# Autodesk Inventor assembly: MM0937AN200_G03_803
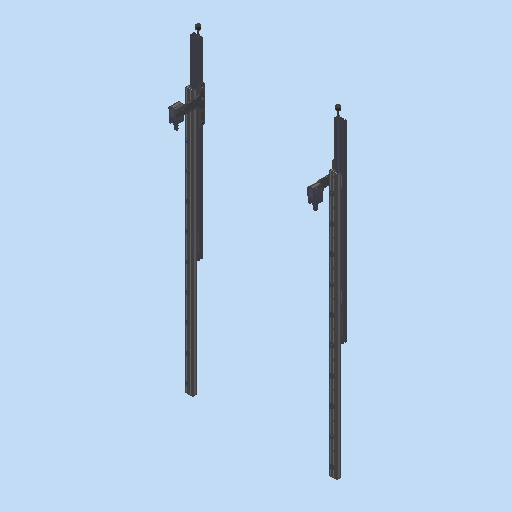
[picture p0: Inventor's stored thumbnail of the model, 512x512]
Saved by Autodesk Inventor 2023.3 (Build 273359000, 359)
## iProperties
Created: 2020-09-01
Part Number: MM0937AN200_G03_803
Material: Generisch
Document SubType Name: Assembly
Designer: Benutzer
Mass: 4640.54 g
Surface Area: 11097.1 cm^2
Volume: 1801.38 cm^3
Density: 2.5761 g/cm^3
Description: =<RBPARTNOTITLE2>
Author: ac91sw
Title: LR_SCHIENE_U_FO_ASM
Sending System: CREO PARAMETRIC BY PTC INC, 2018420
Preprocessor: CREO PARAMETRIC BY PTC INC, 2018420
RBPARTNOTITLE1: Führung
AnP_Kategorie: 1
AnP_Material: =<Material>
RBDRAWINGMISSINGSPEC: --
RBPARTMADEOF: --
RBPARTNOTITLE2: Führungen
RBMATERIAL: =<Material>
RBMATNO: =<Part Number>
Author: Benutzer
Revision Number: 01
Keywords: =<RBPARTMADEOF>
Comments: =<RBSURFACE2>
## Documents named in this file (13)
- C:\Users\rea9an\Documents\Inventor\TCAI2412_te1910_EM\AS00000914.iam
- C:\Users\rea9an\Documents\Inventor\TCAI2412_te1910_EM\PT00004475.ipt
- C:\Users\rea9an\Documents\Inventor\TCAI2412_te1910_EM\PT00004843.ipt
- C:\Users\rea9an\Documents\Inventor\TCAI2412_te1910_EM\PT00004308.ipt
- C:\Users\rea9an\Documents\Inventor\TCAI2412_te1910_EM\PT00004845.ipt
- C:\Users\rea9an\Documents\Inventor\TCAI2412_te1910_EM\PT00004787.ipt
- C:\Users\rea9an\Documents\Inventor\TCAI2412_te1910_EM\PT00004780.ipt
- C:\Users\rea9an\Documents\Inventor\TCAI2412_te1910_EM\PT00004820.ipt
- C:\Users\rea9an\Documents\Inventor\TCAI2412_te1910_EM\PT00004813.ipt
- C:\Users\rea9an\Documents\Inventor\TCAI2412_te1910_EM\AS00000982.iam
- C:\Users\rea9an\Documents\Inventor\TCAI2412_te1910_EM\AS00000983.iam
- C:\Users\rea9an\Documents\Inventor\TCAI2412_te1910_EM\PT00004812.ipt
- C:\Users\rea9an\Documents\Inventor\TCAI2412_te1910_EM\PT00004802.ipt
## Components (66 placed, 12 different names)
1. PT00004813:1 — Fluchtend:11, Einfügen:20
2. PT00004475:1 — Fluchtend:2, Fluchtend:3, Fluchtend:4, Fluchtend:5, Fluchtend:15, Passend:2, Fluchtend:25
3. PT00004475:2 — Fluchtend:1, Fluchtend:3, Fluchtend:6, Fluchtend:15
4. PT00004475:3 — Fluchtend:5, Fluchtend:7, Fluchtend:10, Fluchtend:19
5. PT00004475:4 — Fluchtend:6, Fluchtend:7, Fluchtend:8, Fluchtend:10, Fluchtend:12
6. PT00004813:2 — Fluchtend:8, Fluchtend:11, Fluchtend:12, Fluchtend:13, Fluchtend:14, Einfügen:22
7. PT00004812:2 — Passend:1, Fluchtend:16, Passend:2, Fluchtend:17, Fluchtend:18, Einfügen:5, Einfügen:6, Einfügen:7, Einfügen:8, Einfügen:13, Passend:6, Fluchtend:31, Passend:7, Fluchtend:34, Fluchtend:35
8. PT00004812:1 — Fluchtend:17, Fluchtend:18, Fluchtend:19, Einfügen:9, Einfügen:10, Einfügen:11, Einfügen:12, Einfügen:14, Fluchtend:27, Passend:5, Fluchtend:30, Fluchtend:33, Passend:8, Fluchtend:37
9. PT00004845:1 — Einfügen:5
10. PT00004845:2 — Einfügen:6
11. PT00004845:3 — Einfügen:7
12. PT00004845:4 — Einfügen:8
13. PT00004845:5 — Einfügen:9
14. PT00004845:6 — Einfügen:10
15. PT00004845:7 — Einfügen:11
16. PT00004845:8 — Einfügen:12
17. PT00004787:1 — Einfügen:13, Einfügen:16
18. PT00004787:2 — Einfügen:14, Einfügen:15
19. PT00004780:1 — Einfügen:16, Einfügen:17
20. PT00004780:2 — Einfügen:15, Einfügen:18
21. PT00004820:1 — Einfügen:17
22. PT00004820:2 — Einfügen:18
23. AS00000982:1 [sub-assembly] — Passend:5, Fluchtend:30, Fluchtend:32, Fluchtend:33
24. AS00000983:1 [sub-assembly] — Passend:6, Fluchtend:31, Fluchtend:32
25. PT00004802:1 — Passend:7, Fluchtend:34, Fluchtend:35, Fluchtend:36
26. PT00004802:2 — Passend:8, Fluchtend:36, Fluchtend:37
27. PT00004308:2 — Einfügen:19
28. PT00004843:1 — Einfügen:19, Einfügen:20
29. PT00004308:3
30. PT00004843:3
31. PT00004308:4
32. PT00004843:4
33. PT00004308:5
34. PT00004843:5
35. PT00004308:6
36. PT00004843:6
37. PT00004308:7
38. PT00004843:7
39. PT00004308:8
40. PT00004843:8
41. PT00004308:9
42. PT00004843:9
43. PT00004308:10
44. PT00004843:10
45. PT00004308:11
46. PT00004843:11
47. PT00004843:2 — Einfügen:21, Einfügen:22
48. PT00004308:1 — Einfügen:21
49. PT00004843:12
50. PT00004308:12
51. PT00004843:13
52. PT00004308:13
53. PT00004843:14
54. PT00004308:14
55. PT00004843:15
56. PT00004308:15
57. PT00004843:16
58. PT00004308:16
59. PT00004843:17
60. PT00004308:17
61. PT00004843:18
62. PT00004308:18
63. PT00004843:19
64. PT00004308:19
65. PT00004843:20
66. PT00004308:20
## Component patterns: (10 elements, first: PT00004308:2 + PT00004843:1), (10 elements, first: PT00004843:2 + PT00004308:1)
## Relationships (53: Flush 29, Insert 18, Mate 6)
- Fluchtend:1 [Flush]: PT00004475:2
- Fluchtend:2 [Flush]: PT00004475:1
- Fluchtend:3 [Flush]: PT00004475:1 ↔ PT00004475:2
- Fluchtend:4 [Flush] (15 mm): PT00004475:1
- Fluchtend:5 [Flush]: PT00004475:1 ↔ PT00004475:3
- Fluchtend:6 [Flush]: PT00004475:2 ↔ PT00004475:4
- Fluchtend:7 [Flush]: PT00004475:3 ↔ PT00004475:4
- Fluchtend:8 [Flush]: PT00004475:4 ↔ PT00004813:2
- Fluchtend:10 [Flush]: PT00004475:3 ↔ PT00004475:4
- Fluchtend:11 [Flush]: PT00004813:1 ↔ PT00004813:2
- Fluchtend:12 [Flush] (-15 mm): PT00004475:4 ↔ PT00004813:2
- Fluchtend:13 [Flush]: PT00004813:2
- Fluchtend:14 [Flush] (685 mm): PT00004813:2
- Fluchtend:15 [Flush] (475 mm): PT00004475:1 ↔ PT00004475:2
- Passend:1 [Mate] (23 mm): PT00004812:2
- Fluchtend:16 [Flush]: PT00004812:2
- Passend:2 [Mate] (245 mm): PT00004475:1 ↔ PT00004812:2
- Fluchtend:17 [Flush]: PT00004812:2 ↔ PT00004812:1
- Fluchtend:18 [Flush]: PT00004812:2 ↔ PT00004812:1
- Fluchtend:19 [Flush]: PT00004475:3 ↔ PT00004812:1
- Fluchtend:25 [Flush] (-43 mm): PT00004475:1
- Einfügen:5 [Insert]: PT00004812:2 ↔ PT00004845:1
- Einfügen:6 [Insert]: PT00004812:2 ↔ PT00004845:2
- Einfügen:7 [Insert]: PT00004812:2 ↔ PT00004845:3
- Einfügen:8 [Insert]: PT00004812:2 ↔ PT00004845:4
- Einfügen:9 [Insert]: PT00004812:1 ↔ PT00004845:5
- Einfügen:10 [Insert]: PT00004812:1 ↔ PT00004845:6
- Einfügen:11 [Insert]: PT00004812:1 ↔ PT00004845:7
- Einfügen:12 [Insert]: PT00004812:1 ↔ PT00004845:8
- Einfügen:13 [Insert] (35 mm): PT00004812:2 ↔ PT00004787:1
- Einfügen:14 [Insert] (35 mm): PT00004812:1 ↔ PT00004787:2
- Einfügen:15 [Insert] (10 mm): PT00004787:2 ↔ PT00004780:2
- Einfügen:16 [Insert] (10 mm): PT00004787:1 ↔ PT00004780:1
- Einfügen:17 [Insert]: PT00004780:1 ↔ PT00004820:1
- Einfügen:18 [Insert]: PT00004780:2 ↔ PT00004820:2
- Fluchtend:27 [Flush] (-362.5 mm): PT00004812:1
- Fluchtend:29 [Flush]
- Einfügen:19 [Insert]: PT00004308:2 ↔ PT00004843:1
- Einfügen:20 [Insert]: PT00004813:1 ↔ PT00004843:1
- Einfügen:21 [Insert]: PT00004843:2 ↔ PT00004308:1
- Einfügen:22 [Insert]: PT00004813:2 ↔ PT00004843:2
- Passend:5 [Mate]: PT00004812:1 ↔ AS00000982:1
- Fluchtend:30 [Flush]: PT00004812:1 ↔ AS00000982:1
- Passend:6 [Mate]: PT00004812:2 ↔ AS00000983:1
- Fluchtend:31 [Flush]: PT00004812:2 ↔ AS00000983:1
- Fluchtend:32 [Flush]: AS00000982:1 ↔ AS00000983:1
- Fluchtend:33 [Flush] (180 mm): PT00004812:1 ↔ AS00000982:1
- Passend:7 [Mate]: PT00004812:2 ↔ PT00004802:1
- Fluchtend:34 [Flush] (30 mm): PT00004812:2 ↔ PT00004802:1
- Fluchtend:35 [Flush] (1 mm): PT00004812:2 ↔ PT00004802:1
- Passend:8 [Mate]: PT00004812:1 ↔ PT00004802:2
- Fluchtend:36 [Flush]: PT00004802:1 ↔ PT00004802:2
- Fluchtend:37 [Flush] (1 mm): PT00004812:1 ↔ PT00004802:2
